# Autodesk Inventor assembly: MM0937AN100_G16_006
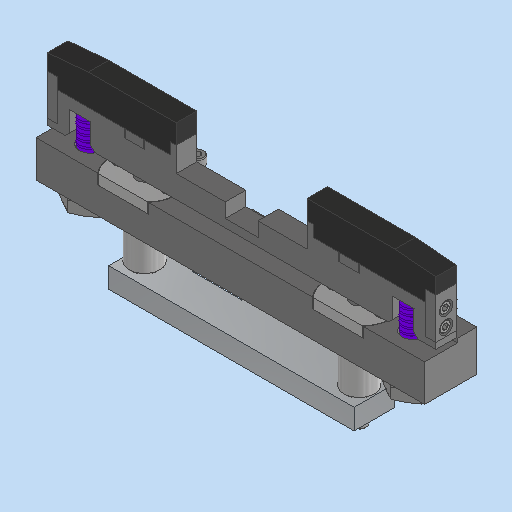
[picture p0: Inventor's stored thumbnail of the model, 512x512]
Saved by Autodesk Inventor 2023.3 (Build 273359000, 359)
## iProperties
Created: 2024-03-19
Part Number: MM0937AN100_G16_006
Description: =<RBPARTNOTITLE2>
Document SubType Name: Assembly
Designer: RIC7AN
Mass: 974.61 g
Surface Area: 748.627 cm^2
Volume: 162.62 cm^3
Density: 5.99316 g/cm^3
RBPARTMADEOF: --
RBDRAWINGMISSINGSPEC: --
AnP_Kategorie: 99
RBPARTNOTITLE2: WT Abstuetzung
RBSURFACE: --
RBPARTNOTITLE1: wpc support
AnP_Material: =<Material>
RBMATERIAL: =<Material>
RBMATNO: =<Part Number>
RBPARTNO: SIEHE MNR
Author: RIC7AN
Keywords: =<RBPARTMADEOF>
Comments: =<RBSURFACE2>
Revision Number: 01
## Documents named in this file (17)
- C:\Users\rea9an\Documents\Inventor\TCAI2412_te1910_EM\AS00000912.iam
- C:\Users\rea9an\Documents\Inventor\TCAI2412_te1910_EM\PT00004551.ipt
- C:\Users\rea9an\Documents\Inventor\TCAI2412_te1910_EM\PT00004552.ipt
- C:\Users\rea9an\Documents\Inventor\TCAI2412_te1910_EM\PT00004553.ipt
- C:\Users\rea9an\Documents\Inventor\TCAI2412_te1910_EM\PT00004559.ipt
- C:\Users\rea9an\Documents\Inventor\TCAI2412_te1910_EM\PT00004554.ipt
- C:\Users\rea9an\Documents\Inventor\TCAI2412_te1910_EM\PT00004555.ipt
- C:\Users\rea9an\Documents\Inventor\TCAI2412_te1910_EM\PT00004558.ipt
- C:\Users\rea9an\Documents\Inventor\TCAI2412_te1910_EM\PT00004560.ipt
- C:\Users\rea9an\Documents\Inventor\TCAI2412_te1910_EM\PT00004556.ipt
- C:\Users\rea9an\Documents\Inventor\TCAI2412_te1910_EM\PT00004864.ipt
- C:\Users\rea9an\Documents\Inventor\TCAI2412_te1910_EM\PT00004857.ipt
- C:\Users\rea9an\Documents\Inventor\TCAI2412_te1910_EM\PT00004867.ipt
- C:\Users\rea9an\Documents\Inventor\TCAI2412_te1910_EM\PT00004916.ipt
- C:\Users\rea9an\Documents\Inventor\TCAI2412_te1910_EM\PT00004561.ipt
- C:\Users\rea9an\Documents\Inventor\TCAI2412_te1910_EM\PT00004818.ipt
- C:\Users\rea9an\Documents\Inventor\TCAI2412_te1910_EM\PT00004775.ipt
## Components (37 placed, 16 different names)
1. PT00004551:1 — Fluchtend:2, Passend:1, Einfügen:8, Einfügen:27, Einfügen:28
2. PT00004552:1
3. PT00004552:2 — Fluchtend:2
4. PT00004553:1 — Passend:1
5. PT00004559:1
6. PT00004559:2
7. PT00004554:1 — Einfügen:29, Einfügen:30
8. PT00004555:1
9. PT00004555:2
10. PT00004558:1
11. PT00004558:2
12. PT00004560:1 — Einfügen:8
13. PT00004560:2
14. PT00004556:1
15. PT00004556:2
16. PT00004864:1
17. PT00004864:2
18. PT00004864:3
19. PT00004864:4
20. PT00004857:1
21. PT00004857:2
22. PT00004857:3
23. PT00004857:4
24. PT00004867:1
25. PT00004867:2
26. PT00004867:3
27. PT00004867:4
28. PT00004916:1
29. PT00004916:2
30. PT00004561:1
31. PT00004561:2
32. PT00004867:5
33. PT00004867:6
34. PT00004818:1 — Einfügen:27
35. PT00004818:2 — Einfügen:28
36. PT00004775:1 — Einfügen:29
37. PT00004775:2 — Einfügen:30
## Relationships (42: Insert 30, Flush 7, Mate 5)
- [Flush] (-33 mm): PT00004551:1 ↔ PT00004552:1
- Fluchtend:2 [Flush] (-33 mm): PT00004551:1 ↔ PT00004552:2
- [Flush]: PT00004551:1 ↔ PT00004552:2
- [Flush]: PT00004551:1 ↔ PT00004552:1
- [Flush] (5.5 mm): PT00004551:1 ↔ PT00004552:1
- [Flush] (5.5 mm): PT00004551:1 ↔ PT00004552:2
- Passend:1 [Mate] (0.5 mm): PT00004551:1 ↔ PT00004553:1
- [Flush] (5.5 mm): PT00004551:1 ↔ PT00004553:1
- [Insert]: PT00004551:1 ↔ PT00004559:2
- [Insert]: PT00004551:1 ↔ PT00004559:1
- [Insert]: PT00004553:1 ↔ PT00004555:2
- [Insert]: PT00004553:1 ↔ PT00004555:1
- [Insert] (0.5 mm): PT00004554:1 ↔ PT00004555:2
- [Insert] (0.5 mm): PT00004554:1 ↔ PT00004555:1
- [Mate]: PT00004558:1 ↔ PT00004560:2
- [Mate]: PT00004558:2 ↔ PT00004560:1
- [Mate]: PT00004558:1 ↔ PT00004560:2
- [Mate]: PT00004558:2 ↔ PT00004560:1
- [Insert] (-9 mm): PT00004551:1 ↔ PT00004560:2
- Einfügen:8 [Insert] (-9 mm): PT00004551:1 ↔ PT00004560:1
- [Insert]: PT00004553:1 ↔ PT00004556:1
- [Insert]: PT00004553:1 ↔ PT00004556:1
- [Insert]: PT00004553:1 ↔ PT00004556:2
- [Insert]: PT00004553:1 ↔ PT00004556:2
- [Insert]: PT00004559:2 ↔ PT00004857:1
- [Insert]: PT00004559:2 ↔ PT00004857:2
- [Insert]: PT00004559:1 ↔ PT00004857:3
- [Insert]: PT00004559:1 ↔ PT00004857:4
- [Insert]: PT00004556:1 ↔ PT00004864:4
- [Insert]: PT00004556:1 ↔ PT00004864:3
- [Insert]: PT00004556:2 ↔ PT00004864:2
- [Insert]: PT00004556:2 ↔ PT00004864:1
- [Insert]: PT00004551:1 ↔ PT00004916:1
- [Insert]: PT00004551:1 ↔ PT00004916:2
- [Insert]: PT00004554:1 ↔ PT00004561:1
- [Insert]: PT00004554:1 ↔ PT00004561:2
- [Insert]: PT00004561:1 ↔ PT00004867:5
- [Insert]: PT00004561:2 ↔ PT00004867:6
- Einfügen:27 [Insert]: PT00004551:1 ↔ PT00004818:1
- Einfügen:28 [Insert]: PT00004551:1 ↔ PT00004818:2
- Einfügen:29 [Insert]: PT00004554:1 ↔ PT00004775:1
- Einfügen:30 [Insert]: PT00004554:1 ↔ PT00004775:2
